# Autodesk Inventor assembly: Zlozeniowkaiam
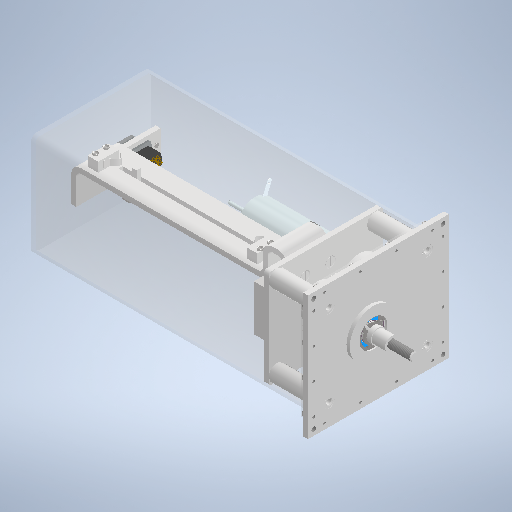
[picture p0: Inventor's stored thumbnail of the model, 512x512]
Saved by Autodesk Inventor 2025.2 (Build 292293000, 293)
## iProperties
Created: 2025-04-06
Part Number: Zlozeniowkaiam
Document SubType Name: Assembly
Designer: makst
Author: makst
## Documents named in this file (39)
- C:\Users\makst\OneDrive\Dokumenty\Inventor\ZNL\Zlozeniowkaiam.iam
- C:\Users\makst\OneDrive\Dokumenty\Inventor\ZNL\Nakrętka.ipt
- C:\Users\makst\OneDrive\Dokumenty\Inventor\ZNL\popychacz.ipt
- C:\Users\makst\OneDrive\Dokumenty\Inventor\ZNL\sprzeglo_przód.ipt
- C:\Users\makst\OneDrive\Dokumenty\Inventor\ZNL\sprzeglo_tył.ipt
- C:\Users\makst\OneDrive\Dokumenty\Inventor\Content Center Files\R2025\en-US\KS B 1336(2)\KS B 1336 - 17x1.ipt
- C:\Users\makst\OneDrive\Dokumenty\Inventor\ZNL\łożysko.ipt
- C:\Users\makst\OneDrive\Dokumenty\Inventor\ZNL\Tuleja_lożyskowa.ipt
- C:\Users\makst\OneDrive\Dokumenty\Inventor\ZNL\Kola_zebate.iam
- C:\Users\makst\OneDrive\Dokumenty\Inventor\ZNL\zespol_silnik_i_reduktor.iam
- C:\Users\makst\OneDrive\Dokumenty\Inventor\ZNL\podkladkaipt.ipt
- C:\Users\makst\OneDrive\Dokumenty\Inventor\Content Center Files\R2025\en-US\DIN 471(3)\DIN 471 - 9 x 1.ipt
- C:\Users\makst\OneDrive\Dokumenty\Inventor\ZNL\sprezyna (3).ipt
- C:\Users\makst\OneDrive\Dokumenty\Inventor\ZNL\projektkajtka\płyta_tylna.ipt
- C:\Users\makst\OneDrive\Dokumenty\Inventor\Content Center Files\R2025\en-US\ANSI B18.3.6M(02)\ANSI B18.3.6M - M2x0,4 x 2,5(6).ipt
- C:\Users\makst\OneDrive\Dokumenty\Inventor\ZNL\projektkajtka\podkładka_sprężyna.ipt
- C:\Users\makst\OneDrive\Dokumenty\Inventor\Content Center Files\R2025\en-US\DIN EN ISO 4026\DIN EN ISO 4026 - M2 x 2.ipt
- C:\Users\makst\OneDrive\Dokumenty\Inventor\ZNL\projektkajtka\tarcza.ipt
- C:\Users\makst\OneDrive\Dokumenty\Inventor\ZNL\projektkajtka\enkoder.ipt
- C:\Users\makst\OneDrive\Dokumenty\Inventor\ZNL\projektkajtka\tuleja_łożyskowa_enkoder.ipt
- C:\Users\makst\OneDrive\Dokumenty\Inventor\ZNL\projektkajtka\płyta_przednia.ipt
- C:\Users\makst\OneDrive\Dokumenty\Inventor\ZNL\projektkajtka\wspornik.ipt
- C:\Users\makst\OneDrive\Dokumenty\Inventor\ZNL\Blacha.ipt
- C:\Users\makst\OneDrive\Dokumenty\Inventor\ZNL\projektkajtka\krańcówka.ipt
- C:\Users\makst\OneDrive\Dokumenty\Inventor\ZNL\projektkajtka\obudowa.ipt
- C:\Users\makst\OneDrive\Dokumenty\Inventor\ZNL\nakładka na popychacz.ipt
- C:\Users\makst\OneDrive\Dokumenty\Inventor\Content Center Files\R2025\en-US\D-Sub Male Crimp\D-Sub Male Crimp 15CKT.ipt
- C:\Users\makst\OneDrive\Dokumenty\Inventor\Content Center Files\R2025\en-US\BS 1804\BS 1804-2 - 2 x 10.ipt
- C:\Users\makst\OneDrive\Dokumenty\Inventor\Content Center Files\R2025\en-US\BS EN ISO 7045 Z\EN ISO 7045 - M3 x 4 - 4.8 - Z(1).ipt
- C:\Users\makst\OneDrive\Dokumenty\Inventor\Content Center Files\R2025\en-US\BS EN ISO 7045 Z\EN ISO 7045 - M1,6 x 12 - 4.8 - Z(1).ipt
- C:\Users\makst\OneDrive\Dokumenty\Inventor\Content Center Files\R2025\en-US\BS EN ISO 7045 Z\EN ISO 7045 - M1,6 x 8 - 4.8 - Z(1).ipt
- C:\Users\makst\OneDrive\Dokumenty\Inventor\Content Center Files\R2025\en-US\BS EN ISO 7045 Z\EN ISO 7045 - M2 x 4 - 4.8 - Z(1).ipt
- C:\Users\makst\OneDrive\Dokumenty\Inventor\Content Center Files\R2025\en-US\AS 1474(1)\AS 1474 - M4(1).ipt
- C:\Users\makst\OneDrive\Dokumenty\Inventor\Content Center Files\R2025\en-US\DIN EN ISO 4026\DIN EN ISO 4026 - M2 x 2,5.ipt
- C:\Users\makst\OneDrive\Dokumenty\Inventor\Content Center Files\R2025\en-US\KS B 1021(2)\KS B 1021 - M 3 x 10(4).ipt
- C:\Users\makst\OneDrive\Dokumenty\Inventor\ZNL\projektkajtka\koszyczek silnikowy.ipt
- C:\Users\makst\OneDrive\Dokumenty\Inventor\Content Center Files\R2025\en-US\AS 1427(10)\AS 1427 - M2 x 8(7).ipt
- C:\Users\makst\OneDrive\Dokumenty\Inventor\Content Center Files\R2025\en-US\DIN EN ISO 7089\DIN EN ISO 7089 -  2,5.ipt
- C:\Users\makst\OneDrive\Dokumenty\Inventor\Content Center Files\R2025\en-US\BS EN ISO 7045 Z\EN ISO 7045 - M2,5 x 8 - 4.8 - Z(1).ipt
## Components (78 placed, 38 different names)
1. Nakrętka:1 — Mate:8, Mate:9, Mate:10, Mate:11, Mate:14, Mate:15, Mate:16, Mate:17, Mate:18, Mate:19, Mate:20, Mate:31, Mate:32, Mate:37, Mate:43, Mate:44, Tangent:1, Mate:102, Angle:6, Insert:36, Mate:133
2. popychacz:1 — Mate:102, Mate:112, Mate:114, Mate:145
3. sprzeglo_przód:1 — Mate:19, Mate:22, Mate:36
4. sprzeglo_tył:1 — Mate:18, Mate:21, Mate:23, Mate:24, Mate:30
5. łożysko:1 — Mate:8, Mate:9, Mate:52, Mate:106, Flush:4
6. łożysko:2 — Mate:11, Mate:134
7. Tuleja_lożyskowa:2 — Mate:10, Mate:58, Mate:119, Insert:37, Insert:38
8. Kola_zebate:1 [sub-assembly] — Mate:20, Mate:21, Mate:22, Mate:25, Flush:5, Mate:129
9. zespol_silnik_i_reduktor:1 [sub-assembly] — Mate:25, Mate:26, Angle:5, Flush:5, Mate:130, Mate:137, Mate:146, Mate:147
10. podkladkaipt:1 — Mate:133, Mate:134
11. DIN 471 <= 9mm 9 x 1:1 — Mate:14, Mate:15
12. DIN 471 <= 9mm 9 x 1:2 — Mate:16, Mate:17
13. sprezyna (3):1 — Mate:23, Mate:24, Mate:33
14. płyta_tylna:1 — Mate:26, Mate:48, Mate:50, Flush:3, Angle:1, Mate:53, Angle:2, Mate:107, Angle:5, Mate:131, Mate:132, Angle:6, Angle:7, Mate:148, Mate:149, Mate:151, Mate:153, Mate:154, Mate:155, Mate:156, Mate:157, Mate:158, Mate:162
15. Broached Hexagon Socket Set Screw - Half Dog Point - Metric M2x0,4 x 2,5:1 — Mate:30, Mate:31
16. podkładka_sprężyna:1 — Mate:32, Mate:33
17. DIN EN ISO 4026 M2 x 2:1 — Mate:36, Mate:37
18. tarcza:2 — Mate:43, Mate:44, Mate:45
19. DIN EN ISO 4026 M2 x 2:2 — Mate:45, Tangent:1, Angle:7
20. enkoder:1 — Mate:54, Mate:55, Mate:56, Mate:83, Mate:84, Insert:5, Insert:7
21. tuleja_łożyskowa_enkoder:1 — Angle:1, Mate:52, Mate:53, Mate:54, Mate:55, Mate:56, Mate:63, Mate:64, Mate:65, Mate:81, Mate:82, Mate:106, Flush:4, Mate:107
22. płyta_przednia:1 — Mate:58, Angle:2, Mate:59, Mate:60, Mate:61, Mate:62, Mate:70, Mate:93, Mate:94, Mate:115, Mate:116, Mate:117, Mate:118, Mate:119
23. wspornik:1 — Mate:59, Mate:118
24. wspornik:2 — Mate:60, Mate:117
25. wspornik:3 — Mate:61, Mate:116
26. wspornik:4 — Mate:62, Mate:115
27. Blacha:1 — Mate:63, Mate:64, Mate:65, Mate:68, Mate:75, Mate:76, Mate:77, Mate:78, Mate:79, Mate:99, Mate:100, Angle:3, Mate:108, Mate:109, Angle:4
28. krańcówka:1 — Mate:68, Mate:75, Mate:76, Mate:85, Mate:86, Insert:11
29. krańcówka:2 — Mate:77, Mate:78, Mate:79, Insert:9, Insert:10
30. obudowa:1 — Mate:70, Mate:93, Mate:94, Insert:12, Insert:13, Insert:14, Insert:15, Insert:16, Insert:17, Insert:18, Insert:19, Insert:20, Insert:21, Insert:22, Insert:23, Insert:24, Insert:25, Insert:26, Insert:27
31. nakładka na popychacz:1 — Insert:30, Mate:112, Mate:114, Angle:4, Mate:145
32. BS 1804 : Part 2 2 x 10:1 — Mate:82, Mate:84
33. BS 1804 : Part 2 2 x 10:2 — Mate:81, Mate:83
34. BS EN ISO 7045 Z - Metric M1,6 x 12 - 4.8 - Z:1 — Insert:5
35. BS EN ISO 7045 Z - Metric M1,6 x 12 - 4.8 - Z:3 — Insert:7
36. BS EN ISO 7045 Z - Metric M1,6 x 8 - 4.8 - Z:1 — Insert:9
37. BS EN ISO 7045 Z - Metric M1,6 x 8 - 4.8 - Z:2 — Insert:10
38. BS EN ISO 7045 Z - Metric M1,6 x 8 - 4.8 - Z:3 — Mate:85, Mate:86
39. BS EN ISO 7045 Z - Metric M1,6 x 8 - 4.8 - Z:4 — Insert:11
40. BS EN ISO 7045 Z - Metric M2 x 4 - 4.8 - Z:1 — Insert:12
41. BS EN ISO 7045 Z - Metric M2 x 4 - 4.8 - Z:2 — Insert:13
42. BS EN ISO 7045 Z - Metric M2 x 4 - 4.8 - Z:3 — Insert:14
43. BS EN ISO 7045 Z - Metric M2 x 4 - 4.8 - Z:4 — Insert:15
44. BS EN ISO 7045 Z - Metric M2 x 4 - 4.8 - Z:5 — Insert:16
45. BS EN ISO 7045 Z - Metric M2 x 4 - 4.8 - Z:6 — Insert:17
46. BS EN ISO 7045 Z - Metric M2 x 4 - 4.8 - Z:7 — Insert:18
47. BS EN ISO 7045 Z - Metric M2 x 4 - 4.8 - Z:8 — Insert:19
48. BS EN ISO 7045 Z - Metric M2 x 4 - 4.8 - Z:9 — Insert:20
49. BS EN ISO 7045 Z - Metric M2 x 4 - 4.8 - Z:10 — Insert:21
50. BS EN ISO 7045 Z - Metric M2 x 4 - 4.8 - Z:11 — Insert:22
51. BS EN ISO 7045 Z - Metric M2 x 4 - 4.8 - Z:12 — Insert:23
52. BS EN ISO 7045 Z - Metric M2 x 4 - 4.8 - Z:13 — Insert:24
53. BS EN ISO 7045 Z - Metric M2 x 4 - 4.8 - Z:14 — Insert:25
54. BS EN ISO 7045 Z - Metric M2 x 4 - 4.8 - Z:15 — Insert:26
55. BS EN ISO 7045 Z - Metric M2 x 4 - 4.8 - Z:16 — Insert:27
56. D-Sub Male Crimp D-Sub Male Crimp 15CKT:2 — Mate:99, Mate:100, Angle:3, Mate:110, Mate:111
57. AS 1474 - Metric M4:1 — Insert:30, Insert:31, Angle:8
58. AS 1474 - Metric M4:2 — Insert:31, Angle:8
59. BS EN ISO 7045 Z - Metric M3 x 4 - 4.8 - Z:3 — Mate:108, Mate:110
60. BS EN ISO 7045 Z - Metric M3 x 4 - 4.8 - Z:4 — Mate:109, Mate:111
61. DIN EN ISO 4026 M2 x 2,5:1 — Mate:129, Mate:130
62. KS B 1021 - Metric M 3 x 10:3 — Mate:131
63. KS B 1021 - Metric M 3 x 10:4 — Mate:132
64. DIN 471 <= 9mm 9 x 1:3 — Insert:36
65. KS B 1336 17x1:1 — Insert:37
66. KS B 1336 17x1:2 — Insert:38
67. koszyczek silnikowy:1 — Mate:137, Mate:146, Mate:147, Mate:148, Insert:39, Insert:40, Insert:41
68. AS 1427 (8) - Metric M2 x 8:1 — Insert:39
69. AS 1427 (8) - Metric M2 x 8:2 — Insert:40
70. AS 1427 (8) - Metric M2 x 8:3 — Insert:41
71. DIN EN ISO 7089 2,5:1 — Mate:154, Mate:158, Mate:159, Mate:166
72. DIN EN ISO 7089 2,5:2 — Mate:149, Mate:151, Mate:163
73. DIN EN ISO 7089 2,5:3 — Mate:153, Mate:156, Mate:161, Mate:164
74. DIN EN ISO 7089 2,5:4 — Mate:155, Mate:157, Mate:160, Mate:165
75. BS EN ISO 7045 Z - Metric M2,5 x 8 - 4.8 - Z:1 — Mate:161, Mate:164
76. BS EN ISO 7045 Z - Metric M2,5 x 8 - 4.8 - Z:2 — Mate:162, Mate:163
77. BS EN ISO 7045 Z - Metric M2,5 x 8 - 4.8 - Z:3 — Mate:160, Mate:165
78. BS EN ISO 7045 Z - Metric M2,5 x 8 - 4.8 - Z:4 — Mate:159, Mate:166
## Relationships (142: Mate 100, Insert 29, Angle 8, Flush 4, Tangent 1)
- [Mate]: łożysko:2 ↔ Tuleja_lożyskowa:2
- [Flush]: łożysko:2 ↔ Tuleja_lożyskowa:2
- Mate:8: Nakrętka:1 ↔ łożysko:1
- Mate:9: Nakrętka:1 ↔ łożysko:1
- Mate:10: Nakrętka:1 ↔ Tuleja_lożyskowa:2
- Mate:11: Nakrętka:1 ↔ łożysko:2
- Mate:14: Nakrętka:1 ↔ DIN 471 <= 9mm 9 x 1:1
- Mate:15: Nakrętka:1 ↔ DIN 471 <= 9mm 9 x 1:1
- Mate:16: Nakrętka:1 ↔ DIN 471 <= 9mm 9 x 1:2
- Mate:17: Nakrętka:1 ↔ DIN 471 <= 9mm 9 x 1:2
- Mate:18: Nakrętka:1 ↔ sprzeglo_tył:1
- Mate:19: Nakrętka:1 ↔ sprzeglo_przód:1
- Mate:20: Nakrętka:1 ↔ Kola_zebate:1
- Mate:21: sprzeglo_tył:1 ↔ Kola_zebate:1
- Mate:22: sprzeglo_przód:1 ↔ Kola_zebate:1
- Mate:23: sprzeglo_tył:1 ↔ sprezyna (3):1
- Mate:24: sprzeglo_tył:1 ↔ sprezyna (3):1
- Mate:25: Kola_zebate:1 ↔ zespol_silnik_i_reduktor:1
- Mate:26: zespol_silnik_i_reduktor:1 ↔ płyta_tylna:1
- Mate:30: sprzeglo_tył:1 ↔ Broached Hexagon Socket Set Screw - Half Dog Point - Metric M2x0,4 x 2,5:1
- Mate:31: Nakrętka:1 ↔ Broached Hexagon Socket Set Screw - Half Dog Point - Metric M2x0,4 x 2,5:1
- Mate:32: Nakrętka:1 ↔ podkładka_sprężyna:1
- Mate:33: sprezyna (3):1 ↔ podkładka_sprężyna:1
- Mate:36: sprzeglo_przód:1 ↔ DIN EN ISO 4026 M2 x 2:1
- Mate:37: Nakrętka:1 ↔ DIN EN ISO 4026 M2 x 2:1
- Mate:43: Nakrętka:1 ↔ tarcza:2
- Mate:44: Nakrętka:1 ↔ tarcza:2
- Mate:45: tarcza:2 ↔ DIN EN ISO 4026 M2 x 2:2
- Tangent:1: Nakrętka:1 ↔ DIN EN ISO 4026 M2 x 2:2
- Mate:48: płyta_tylna:1
- Mate:50: płyta_tylna:1
- Flush:3: płyta_tylna:1
- Angle:1 (0 deg): płyta_tylna:1 ↔ tuleja_łożyskowa_enkoder:1
- Mate:52: łożysko:1 ↔ tuleja_łożyskowa_enkoder:1
- Mate:53: płyta_tylna:1 ↔ tuleja_łożyskowa_enkoder:1
- Mate:54: enkoder:1 ↔ tuleja_łożyskowa_enkoder:1
- Mate:55: enkoder:1 ↔ tuleja_łożyskowa_enkoder:1
- Mate:56: enkoder:1 ↔ tuleja_łożyskowa_enkoder:1
- Mate:58: Tuleja_lożyskowa:2 ↔ płyta_przednia:1
- Angle:2 (0 deg): płyta_tylna:1 ↔ płyta_przednia:1
- Mate:59: płyta_przednia:1 ↔ wspornik:1
- Mate:60: płyta_przednia:1 ↔ wspornik:2
- Mate:61: płyta_przednia:1 ↔ wspornik:3
- Mate:62: płyta_przednia:1 ↔ wspornik:4
- Mate:63: tuleja_łożyskowa_enkoder:1 ↔ Blacha:1
- Mate:64: tuleja_łożyskowa_enkoder:1 ↔ Blacha:1
- Mate:65: tuleja_łożyskowa_enkoder:1 ↔ Blacha:1
- Mate:68: Blacha:1 ↔ krańcówka:1
- Mate:70: płyta_przednia:1 ↔ obudowa:1
- Mate:75: Blacha:1 ↔ krańcówka:1
- Mate:76: Blacha:1 ↔ krańcówka:1
- Mate:77: Blacha:1 ↔ krańcówka:2
- Mate:78: Blacha:1 ↔ krańcówka:2
- Mate:79: Blacha:1 ↔ krańcówka:2
- Mate:81: tuleja_łożyskowa_enkoder:1 ↔ BS 1804 : Part 2 2 x 10:2
- Mate:82: tuleja_łożyskowa_enkoder:1 ↔ BS 1804 : Part 2 2 x 10:1
- Mate:83: enkoder:1 ↔ BS 1804 : Part 2 2 x 10:2
- Mate:84: enkoder:1 ↔ BS 1804 : Part 2 2 x 10:1
- Insert:5: enkoder:1 ↔ BS EN ISO 7045 Z - Metric M1,6 x 12 - 4.8 - Z:1
- Insert:7: enkoder:1 ↔ BS EN ISO 7045 Z - Metric M1,6 x 12 - 4.8 - Z:3
- Insert:9: krańcówka:2 ↔ BS EN ISO 7045 Z - Metric M1,6 x 8 - 4.8 - Z:1
- Insert:10: krańcówka:2 ↔ BS EN ISO 7045 Z - Metric M1,6 x 8 - 4.8 - Z:2
- Mate:85: krańcówka:1 ↔ BS EN ISO 7045 Z - Metric M1,6 x 8 - 4.8 - Z:3
- Mate:86: krańcówka:1 ↔ BS EN ISO 7045 Z - Metric M1,6 x 8 - 4.8 - Z:3
- Insert:11: krańcówka:1 ↔ BS EN ISO 7045 Z - Metric M1,6 x 8 - 4.8 - Z:4
- Mate:93: płyta_przednia:1 ↔ obudowa:1
- Mate:94: płyta_przednia:1 ↔ obudowa:1
- Insert:12: obudowa:1 ↔ BS EN ISO 7045 Z - Metric M2 x 4 - 4.8 - Z:1
- Insert:13: obudowa:1 ↔ BS EN ISO 7045 Z - Metric M2 x 4 - 4.8 - Z:2
- Insert:14: obudowa:1 ↔ BS EN ISO 7045 Z - Metric M2 x 4 - 4.8 - Z:3
- Insert:15: obudowa:1 ↔ BS EN ISO 7045 Z - Metric M2 x 4 - 4.8 - Z:4
- Insert:16: obudowa:1 ↔ BS EN ISO 7045 Z - Metric M2 x 4 - 4.8 - Z:5
- Insert:17: obudowa:1 ↔ BS EN ISO 7045 Z - Metric M2 x 4 - 4.8 - Z:6
- Insert:18: obudowa:1 ↔ BS EN ISO 7045 Z - Metric M2 x 4 - 4.8 - Z:7
- Insert:19: obudowa:1 ↔ BS EN ISO 7045 Z - Metric M2 x 4 - 4.8 - Z:8
- Insert:20: obudowa:1 ↔ BS EN ISO 7045 Z - Metric M2 x 4 - 4.8 - Z:9
- Insert:21: obudowa:1 ↔ BS EN ISO 7045 Z - Metric M2 x 4 - 4.8 - Z:10
- Insert:22: obudowa:1 ↔ BS EN ISO 7045 Z - Metric M2 x 4 - 4.8 - Z:11
- Insert:23: obudowa:1 ↔ BS EN ISO 7045 Z - Metric M2 x 4 - 4.8 - Z:12
- Insert:24: obudowa:1 ↔ BS EN ISO 7045 Z - Metric M2 x 4 - 4.8 - Z:13
- Insert:25: obudowa:1 ↔ BS EN ISO 7045 Z - Metric M2 x 4 - 4.8 - Z:14
- Insert:26: obudowa:1 ↔ BS EN ISO 7045 Z - Metric M2 x 4 - 4.8 - Z:15
- Insert:27: obudowa:1 ↔ BS EN ISO 7045 Z - Metric M2 x 4 - 4.8 - Z:16
- Mate:99: Blacha:1 ↔ D-Sub Male Crimp D-Sub Male Crimp 15CKT:2
- Mate:100: Blacha:1 ↔ D-Sub Male Crimp D-Sub Male Crimp 15CKT:2
- Mate:102: Nakrętka:1 ↔ popychacz:1
- Insert:30: nakładka na popychacz:1 ↔ AS 1474 - Metric M4:1
- Insert:31: AS 1474 - Metric M4:1 ↔ AS 1474 - Metric M4:2
- Mate:106: łożysko:1 ↔ tuleja_łożyskowa_enkoder:1
- Flush:4: łożysko:1 ↔ tuleja_łożyskowa_enkoder:1
- Mate:107: płyta_tylna:1 ↔ tuleja_łożyskowa_enkoder:1
- Angle:3 (0 deg): Blacha:1 ↔ D-Sub Male Crimp D-Sub Male Crimp 15CKT:2
- Mate:108: Blacha:1 ↔ BS EN ISO 7045 Z - Metric M3 x 4 - 4.8 - Z:3
- Mate:109: Blacha:1 ↔ BS EN ISO 7045 Z - Metric M3 x 4 - 4.8 - Z:4
- Mate:110: D-Sub Male Crimp D-Sub Male Crimp 15CKT:2 ↔ BS EN ISO 7045 Z - Metric M3 x 4 - 4.8 - Z:3
- Mate:111: D-Sub Male Crimp D-Sub Male Crimp 15CKT:2 ↔ BS EN ISO 7045 Z - Metric M3 x 4 - 4.8 - Z:4
- Mate:112: popychacz:1 ↔ nakładka na popychacz:1
- Mate:114: popychacz:1 ↔ nakładka na popychacz:1
- Angle:4 (0 deg): Blacha:1 ↔ nakładka na popychacz:1
- Mate:115: płyta_przednia:1 ↔ wspornik:4
- Mate:116: płyta_przednia:1 ↔ wspornik:3
- Mate:117: płyta_przednia:1 ↔ wspornik:2
- Mate:118: płyta_przednia:1 ↔ wspornik:1
- Mate:119: Tuleja_lożyskowa:2 ↔ płyta_przednia:1
- Angle:5 (0 deg): zespol_silnik_i_reduktor:1 ↔ płyta_tylna:1
- Flush:5: Kola_zebate:1 ↔ zespol_silnik_i_reduktor:1
- Mate:129: Kola_zebate:1 ↔ DIN EN ISO 4026 M2 x 2,5:1
- Mate:130: zespol_silnik_i_reduktor:1 ↔ DIN EN ISO 4026 M2 x 2,5:1
- Mate:131: płyta_tylna:1 ↔ KS B 1021 - Metric M 3 x 10:3
- Mate:132: płyta_tylna:1 ↔ KS B 1021 - Metric M 3 x 10:4
- Angle:6 (0 deg): Nakrętka:1 ↔ płyta_tylna:1
- Angle:7 (0 deg): płyta_tylna:1 ↔ DIN EN ISO 4026 M2 x 2:2
- Insert:36: Nakrętka:1 ↔ DIN 471 <= 9mm 9 x 1:3
- Mate:133: Nakrętka:1 ↔ podkladkaipt:1
- Mate:134: łożysko:2 ↔ podkladkaipt:1
- Insert:37: Tuleja_lożyskowa:2 ↔ KS B 1336 17x1:1
- Insert:38: Tuleja_lożyskowa:2 ↔ KS B 1336 17x1:2
- Mate:137: zespol_silnik_i_reduktor:1 ↔ koszyczek silnikowy:1
- Mate:145: popychacz:1 ↔ nakładka na popychacz:1
- Angle:8 (0 deg): AS 1474 - Metric M4:1 ↔ AS 1474 - Metric M4:2
- Mate:146: zespol_silnik_i_reduktor:1 ↔ koszyczek silnikowy:1
- Mate:147: zespol_silnik_i_reduktor:1 ↔ koszyczek silnikowy:1
- Mate:148: płyta_tylna:1 ↔ koszyczek silnikowy:1
- Insert:39: koszyczek silnikowy:1 ↔ AS 1427 (8) - Metric M2 x 8:1
- Insert:40: koszyczek silnikowy:1 ↔ AS 1427 (8) - Metric M2 x 8:2
- Insert:41: koszyczek silnikowy:1 ↔ AS 1427 (8) - Metric M2 x 8:3
- Mate:149: płyta_tylna:1 ↔ DIN EN ISO 7089 2,5:2
- Mate:151: płyta_tylna:1 ↔ DIN EN ISO 7089 2,5:2
- Mate:153: płyta_tylna:1 ↔ DIN EN ISO 7089 2,5:3
- Mate:154: płyta_tylna:1 ↔ DIN EN ISO 7089 2,5:1
- Mate:155: płyta_tylna:1 ↔ DIN EN ISO 7089 2,5:4
- Mate:156: płyta_tylna:1 ↔ DIN EN ISO 7089 2,5:3
- Mate:157: płyta_tylna:1 ↔ DIN EN ISO 7089 2,5:4
- Mate:158: płyta_tylna:1 ↔ DIN EN ISO 7089 2,5:1
- Mate:159: DIN EN ISO 7089 2,5:1 ↔ BS EN ISO 7045 Z - Metric M2,5 x 8 - 4.8 - Z:4
- Mate:160: DIN EN ISO 7089 2,5:4 ↔ BS EN ISO 7045 Z - Metric M2,5 x 8 - 4.8 - Z:3
- Mate:161: DIN EN ISO 7089 2,5:3 ↔ BS EN ISO 7045 Z - Metric M2,5 x 8 - 4.8 - Z:1
- Mate:162: płyta_tylna:1 ↔ BS EN ISO 7045 Z - Metric M2,5 x 8 - 4.8 - Z:2
- Mate:163: DIN EN ISO 7089 2,5:2 ↔ BS EN ISO 7045 Z - Metric M2,5 x 8 - 4.8 - Z:2
- Mate:164: DIN EN ISO 7089 2,5:3 ↔ BS EN ISO 7045 Z - Metric M2,5 x 8 - 4.8 - Z:1
- Mate:165: DIN EN ISO 7089 2,5:4 ↔ BS EN ISO 7045 Z - Metric M2,5 x 8 - 4.8 - Z:3
- Mate:166: DIN EN ISO 7089 2,5:1 ↔ BS EN ISO 7045 Z - Metric M2,5 x 8 - 4.8 - Z:4
## Named parameters: d13_d3 = 0 mm, d14_d4 = 0 mm
